# Autodesk Inventor assembly: Assembly1
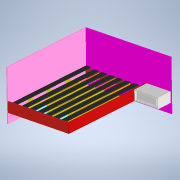
[picture p0: Inventor's stored thumbnail of the model, 180x180]
Saved by Autodesk Inventor 2022.6 (Build 266554000, 554)
## iProperties
Created: 2025-04-23
Part Number: Assembly1
Document SubType Name: Assembly
Designer: Dragos Macovei
Author: Dragos Macovei
## Documents named in this file (13)
- C:\Users\Dragos Macovei\Documents\Inventor_3d_parts\PAT\Pat_Colt_tara_190_125_26\Assembly1.iam
- C:\Users\Dragos Macovei\Documents\Inventor_3d_parts\PAT\Pat_Colt_tara_190_125_26\rama_interior_laterala_dreapta.ipt
- C:\Users\Dragos Macovei\Documents\Inventor_3d_parts\PAT\Pat_Colt_tara_190_125_26\rama_interior_laterala_picioare.ipt
- C:\Users\Dragos Macovei\Documents\Inventor_3d_parts\PAT\Pat_Colt_tara_190_125_26\picior_interior_lung.ipt
- C:\Users\Dragos Macovei\Documents\Inventor_3d_parts\PAT\Pat_Colt_tara_190_125_26\distantier_picioare.ipt
- C:\Users\Dragos Macovei\Documents\Inventor_3d_parts\PAT\Pat_Colt_tara_190_125_26\distantier_subtire.ipt
- C:\Users\Dragos Macovei\Documents\Inventor_3d_parts\PAT\Pat_Colt_tara_190_125_26\distantier_subtire_mai_lung_la_cap.ipt
- C:\Users\Dragos Macovei\Documents\Inventor_3d_parts\PAT\Pat_Colt_tara_190_125_26\laterala_exterioara_lunga.ipt
- C:\Users\Dragos Macovei\Documents\Inventor_3d_parts\PAT\Pat_Colt_tara_190_125_26\front_vizibil_picioare.ipt
- C:\Users\Dragos Macovei\Documents\Inventor_3d_parts\PAT\Pat_Colt_tara_190_125_26\laterala_exterioara_cu_otpiarea.ipt
- C:\Users\Dragos Macovei\Documents\Inventor_3d_parts\PAT\Pat_Colt_tara_190_125_26\front_vizibil_dreapta_.ipt
- C:\Users\Dragos Macovei\Documents\Inventor_3d_parts\PAT\dulap_NOPTIERA.ipt
- C:\Users\Dragos Macovei\Documents\Inventor_3d_parts\PAT\Pat_Colt_tara_190_125_26\somiera.ipt
## Components (30 placed, 12 different names)
1. rama_interior_laterala_picioare:1 — Mate:8, Mate:12, Mate:13, Flush:23, Mate:35, Flush:24, Flush:25, Mate:36, Mate:37, Flush:28
2. rama_interior_laterala_dreapta:2 — Mate:1, Mate:2, Flush:1, Mate:6, Mate:16, Mate:17, Flush:12, Mate:29, Mate:35, Flush:24, Flush:25, Flush:26, Flush:27, Mate:40, Flush:32
3. rama_interior_laterala_picioare:2 — Mate:1, Mate:2, Flush:1, Mate:31, Mate:32, Mate:33, Mate:39, Flush:29
4. picior_interior_lung:2 — Mate:6, Mate:8, Flush:9, Flush:10, Mate:14, Mate:18, Flush:22, Flush:23
5. distantier_picioare:1 — Flush:9, Mate:12
6. distantier_picioare:2 — Flush:10, Mate:13, Mate:14, Mate:48
7. picior_interior_lung:3 — Mate:17, Flush:12, Mate:19, Mate:23, Mate:24, Mate:25, Flush:13, Flush:14, Flush:15, Flush:19, Flush:20, Flush:21, Flush:27, Mate:55, Mate:58
8. picior_interior_lung:4 — Mate:16, Mate:18, Mate:19, Mate:20, Mate:21, Mate:22, Flush:16, Flush:17, Flush:18, Flush:26, Mate:46, Mate:49
9. distantier_subtire:1 — Mate:25, Flush:13, Mate:45
10. distantier_subtire:2 — Mate:24, Flush:14
11. distantier_subtire:3 — Mate:23, Flush:15
12. distantier_subtire:4 — Mate:22, Flush:18
13. distantier_subtire:5 — Mate:21, Flush:17, Mate:29, Mate:47
14. distantier_subtire:6 — Mate:20, Flush:16
15. distantier_subtire_mai_lung_la_cap:1 — Mate:32, Flush:20
16. distantier_subtire_mai_lung_la_cap:2 — Mate:33, Flush:21
17. distantier_subtire_mai_lung_la_cap:3 — Mate:31, Flush:19
18. laterala_exterioara_lunga:1 — Flush:22, Mate:36, Mate:38, Flush:30, Flush:31, Mate:43
19. front_vizibil_picioare:1 — Mate:37, Mate:38, Flush:28, Mate:44
20. laterala_exterioara_cu_otpiarea:1 — Mate:39, Flush:29, Flush:30, Flush:31, Mate:41
21. front_vizibil_dreapta_:1 — Mate:40, Mate:41, Flush:32, Mate:42, Flush:33
22. dulap_NOPTIERA:1 — Mate:42, Flush:33
23. somiera:1 — Mate:49, Mate:54, Mate:56
24. somiera:2 — Mate:48, Mate:53, Mate:54
25. somiera:3 — Mate:47, Mate:52, Mate:53
26. somiera:4 — Mate:46, Mate:51, Mate:52
27. somiera:5 — Mate:45, Mate:50, Mate:51
28. somiera:6 — Mate:43, Mate:44, Mate:50
29. somiera:7 — Mate:55, Mate:56, Mate:57
30. somiera:8 — Mate:57, Mate:58
## Relationships (70: Mate 45, Flush 25)
- Mate:1: rama_interior_laterala_dreapta:2 ↔ rama_interior_laterala_picioare:2
- Mate:2: rama_interior_laterala_dreapta:2 ↔ rama_interior_laterala_picioare:2
- Flush:1: rama_interior_laterala_dreapta:2 ↔ rama_interior_laterala_picioare:2
- Mate:6: rama_interior_laterala_dreapta:2 ↔ picior_interior_lung:2
- Mate:8 (450 mm): rama_interior_laterala_picioare:1 ↔ picior_interior_lung:2
- Flush:9: picior_interior_lung:2 ↔ distantier_picioare:1
- Mate:12: rama_interior_laterala_picioare:1 ↔ distantier_picioare:1
- Flush:10: picior_interior_lung:2 ↔ distantier_picioare:2
- Mate:13: rama_interior_laterala_picioare:1 ↔ distantier_picioare:2
- Mate:14: picior_interior_lung:2 ↔ distantier_picioare:2
- Mate:16: rama_interior_laterala_dreapta:2 ↔ picior_interior_lung:4
- Mate:17: rama_interior_laterala_dreapta:2 ↔ picior_interior_lung:3
- Flush:12: rama_interior_laterala_dreapta:2 ↔ picior_interior_lung:3
- Mate:18 (450 mm): picior_interior_lung:2 ↔ picior_interior_lung:4
- Mate:19 (450 mm): picior_interior_lung:3 ↔ picior_interior_lung:4
- Mate:20: picior_interior_lung:4 ↔ distantier_subtire:6
- Mate:21: picior_interior_lung:4 ↔ distantier_subtire:5
- Mate:22: picior_interior_lung:4 ↔ distantier_subtire:4
- Mate:23: picior_interior_lung:3 ↔ distantier_subtire:3
- Mate:24: picior_interior_lung:3 ↔ distantier_subtire:2
- Mate:25: picior_interior_lung:3 ↔ distantier_subtire:1
- Flush:13: picior_interior_lung:3 ↔ distantier_subtire:1
- Flush:14: picior_interior_lung:3 ↔ distantier_subtire:2
- Flush:15: picior_interior_lung:3 ↔ distantier_subtire:3
- Flush:16: picior_interior_lung:4 ↔ distantier_subtire:6
- Flush:17: picior_interior_lung:4 ↔ distantier_subtire:5
- Flush:18: picior_interior_lung:4 ↔ distantier_subtire:4
- Mate:29 (621 mm): rama_interior_laterala_dreapta:2 ↔ distantier_subtire:5
- Mate:31: rama_interior_laterala_picioare:2 ↔ distantier_subtire_mai_lung_la_cap:3
- Mate:32: rama_interior_laterala_picioare:2 ↔ distantier_subtire_mai_lung_la_cap:1
- Mate:33: rama_interior_laterala_picioare:2 ↔ distantier_subtire_mai_lung_la_cap:2
- Flush:19: picior_interior_lung:3 ↔ distantier_subtire_mai_lung_la_cap:3
- Flush:20: picior_interior_lung:3 ↔ distantier_subtire_mai_lung_la_cap:1
- Flush:21: picior_interior_lung:3 ↔ distantier_subtire_mai_lung_la_cap:2
- Flush:22: picior_interior_lung:2 ↔ laterala_exterioara_lunga:1
- Flush:23: rama_interior_laterala_picioare:1 ↔ picior_interior_lung:2
- Mate:35: rama_interior_laterala_picioare:1 ↔ rama_interior_laterala_dreapta:2
- Flush:24: rama_interior_laterala_picioare:1 ↔ rama_interior_laterala_dreapta:2
- Flush:25: rama_interior_laterala_picioare:1 ↔ rama_interior_laterala_dreapta:2
- Flush:26: rama_interior_laterala_dreapta:2 ↔ picior_interior_lung:4
- Flush:27: rama_interior_laterala_dreapta:2 ↔ picior_interior_lung:3
- Mate:36: rama_interior_laterala_picioare:1 ↔ laterala_exterioara_lunga:1
- Mate:37: rama_interior_laterala_picioare:1 ↔ front_vizibil_picioare:1
- Mate:38: laterala_exterioara_lunga:1 ↔ front_vizibil_picioare:1
- Flush:28: rama_interior_laterala_picioare:1 ↔ front_vizibil_picioare:1
- Mate:39: rama_interior_laterala_picioare:2 ↔ laterala_exterioara_cu_otpiarea:1
- Flush:29: rama_interior_laterala_picioare:2 ↔ laterala_exterioara_cu_otpiarea:1
- Flush:30: laterala_exterioara_lunga:1 ↔ laterala_exterioara_cu_otpiarea:1
- Flush:31: laterala_exterioara_lunga:1 ↔ laterala_exterioara_cu_otpiarea:1
- Mate:40: rama_interior_laterala_dreapta:2 ↔ front_vizibil_dreapta_:1
- Mate:41: laterala_exterioara_cu_otpiarea:1 ↔ front_vizibil_dreapta_:1
- Flush:32: rama_interior_laterala_dreapta:2 ↔ front_vizibil_dreapta_:1
- Mate:42: front_vizibil_dreapta_:1 ↔ dulap_NOPTIERA:1
- Flush:33: front_vizibil_dreapta_:1 ↔ dulap_NOPTIERA:1
- Mate:43: laterala_exterioara_lunga:1 ↔ somiera:6
- Mate:44: front_vizibil_picioare:1 ↔ somiera:6
- Mate:45: distantier_subtire:1 ↔ somiera:5
- Mate:46: picior_interior_lung:4 ↔ somiera:4
- Mate:47: distantier_subtire:5 ↔ somiera:3
- Mate:48: distantier_picioare:2 ↔ somiera:2
- Mate:49: picior_interior_lung:4 ↔ somiera:1
- Mate:50 (70 mm): somiera:5 ↔ somiera:6
- Mate:51 (70 mm): somiera:4 ↔ somiera:5
- Mate:52 (70 mm): somiera:3 ↔ somiera:4
- Mate:53 (70 mm): somiera:2 ↔ somiera:3
- Mate:54 (70 mm): somiera:1 ↔ somiera:2
- Mate:55: picior_interior_lung:3 ↔ somiera:7
- Mate:56 (70 mm): somiera:1 ↔ somiera:7
- Mate:57 (70 mm): somiera:7 ↔ somiera:8
- Mate:58: picior_interior_lung:3 ↔ somiera:8
